# Autodesk Inventor assembly: Ensamblaje1
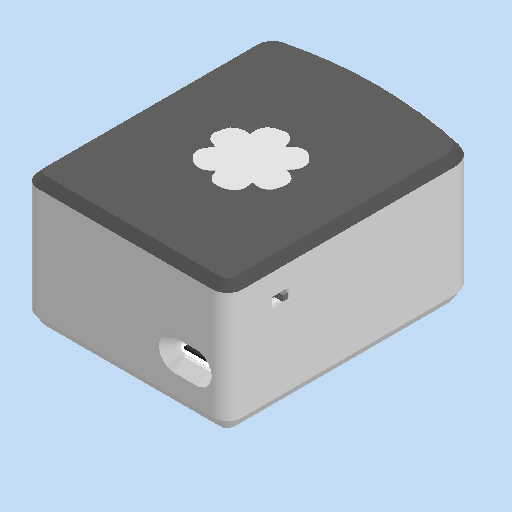
[picture p0: Inventor's stored thumbnail of the model, 512x512]
Saved by Autodesk Inventor 2026.3 (Build 303398000, 398)
## iProperties
Created: 2026-11-10
Part Number: Ensamblaje1
Document SubType Name: Assembly
Designer: Hp
Author: Hp
## Documents named in this file (8)
- C:\Users\Hp\Documents\GitHub\case-moss\stl\Ensamblaje1.iam
- C:\Users\Hp\Documents\GitHub\case-moss\modelos3d\pcb40x60\pcb40x60.ipt
- C:\Users\Hp\Documents\GitHub\case-moss\Pieza5.ipt
- C:\Users\Hp\Documents\GitHub\case-moss\modelos3d\type-c\type-c.ipt
- C:\Users\Hp\Documents\GitHub\case-moss\modelos3d\esp32-wp\esp32-wp.ipt
- C:\Users\Hp\Documents\GitHub\case-moss\stl\Pieza6.ipt
- C:\Users\Hp\Documents\GitHub\case-moss\stl\Pieza1.ipt
- C:\Users\Hp\Documents\GitHub\case-moss\modelos3d\slide-switch\slide-switch.ipt
## Components (8 placed, 7 different names)
1. pcb40x60:1 — Nivelación:1, Nivelación:2, Coincidencia:1, Coincidencia:2, Coincidencia:3, Coincidencia:4, Nivelación:3, Coincidencia:5
2. Pieza5:1 — Nivelación:1, Nivelación:2, Coincidencia:6, Coincidencia:7, Nivelación:4, Nivelación:5, Nivelación:6, Nivelación:7, Nivelación:8, Nivelación:9, Coincidencia:9, Coincidencia:10, Coincidencia:11
3. type-c:1 — Coincidencia:4, Nivelación:3, Coincidencia:5, Coincidencia:8
4. esp32-wp:1 — Coincidencia:1, Coincidencia:2, Coincidencia:3
5. pcb40x60:2 — Coincidencia:6, Coincidencia:7, Coincidencia:8
6. Pieza6:1 — Nivelación:4, Nivelación:5, Nivelación:6, Nivelación:7
7. Pieza1:1 — Nivelación:8, Nivelación:9
8. slide-switch:1 — Coincidencia:9, Coincidencia:10, Coincidencia:11
## Relationships (20: Mate 11, Flush 9)
- Nivelación:1 [Flush]: pcb40x60:1 ↔ Pieza5:1
- Nivelación:2 [Flush]: pcb40x60:1 ↔ Pieza5:1
- Coincidencia:1 [Mate]: pcb40x60:1 ↔ esp32-wp:1
- Coincidencia:2 [Mate]: pcb40x60:1 ↔ esp32-wp:1
- Coincidencia:3 [Mate]: pcb40x60:1 ↔ esp32-wp:1
- Coincidencia:4 [Mate]: pcb40x60:1 ↔ type-c:1
- Nivelación:3 [Flush]: pcb40x60:1 ↔ type-c:1
- Coincidencia:5 [Mate] (-14 mm): pcb40x60:1 ↔ type-c:1
- Coincidencia:6 [Mate]: Pieza5:1 ↔ pcb40x60:2
- Coincidencia:7 [Mate]: Pieza5:1 ↔ pcb40x60:2
- Coincidencia:8 [Mate]: type-c:1 ↔ pcb40x60:2
- Nivelación:4 [Flush]: Pieza5:1 ↔ Pieza6:1
- Nivelación:5 [Flush]: Pieza5:1 ↔ Pieza6:1
- Nivelación:6 [Flush]: Pieza5:1 ↔ Pieza6:1
- Nivelación:7 [Flush]: Pieza5:1 ↔ Pieza6:1
- Nivelación:8 [Flush]: Pieza5:1 ↔ Pieza1:1
- Nivelación:9 [Flush]: Pieza5:1 ↔ Pieza1:1
- Coincidencia:9 [Mate]: Pieza5:1 ↔ slide-switch:1
- Coincidencia:10 [Mate]: Pieza5:1 ↔ slide-switch:1
- Coincidencia:11 [Mate]: Pieza5:1 ↔ slide-switch:1
